# Autodesk Inventor assembly: SE0004AN001_G01_809
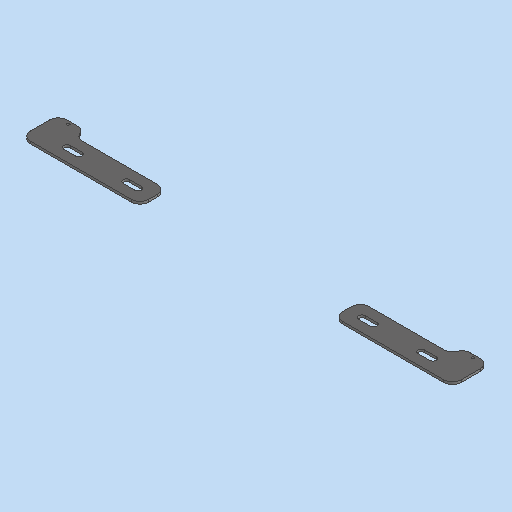
[picture p0: Inventor's stored thumbnail of the model, 512x512]
Saved by Autodesk Inventor 2023.3 (Build 273359000, 359)
## iProperties
RuleStatus: InUse
Created: 2021-07-09
Part Number: SE0004AN001_G01_809
Description: =<RBPARTNOTITLE2>
Document SubType Name: Assembly
Designer: frt9bw
Mass: 553.373 g
Surface Area: 416.53 cm^2
Volume: 72.4798 cm^3
Density: 7.63486 g/cm^3
AnP_Material: =<Material>
AnP_TemplVers: 20200821
RBDOCUMENTTYPE: DRF
RBDOCUMENTVERSION: 00
RBDRAWINGMAINSCALE: 1:1
RBDRAWINGMISSINGSPEC: --
RBDRAWINGVOLUME: --
RBDSV1: 0850
RBGBEDGESIN1: +0,5
RBGBEDGESIN2: +0,2
RBGBEDGESOUT1: -0,3
RBGBEDGESOUT2: -0,1
RBMATERIAL: =<Material>
RBMATMEETS: --
RBMATNO: =<Part Number>
RBPARTMADEOF: --
RBPARTNO: SIEHE MNR
RBPARTNOTITLE1: --
RBPARTSAFETYINDICATOR: --
RBSURFACE: --
RBSURFACE2: --
RBZEDGESNORM: ISO13715:2002-06
RBZGENDIMCLASS: m
RBZGENDIMNORM: ISO 2768-1:1989-11
RBZGENGEOCLASS: H
RBZGENGEONORM: ISO 2768-2:1989-11
RBZSURFACENORM: ISO13D2:2002-02
RBZTOLERANCENORM: ISO 14405-1:2010-12
Author: frt9bw
Keywords: =<RBPARTMADEOF>
Comments: =<RBSURFACE2>
Revision Number: 01
## Documents named in this file (3)
- C:\Users\rea9an\Documents\Inventor\TCAI2412_te1910_EM\AS00000984.iam
- C:\Users\rea9an\Documents\Inventor\TCAI2412_te1910_EM\PT00004801.ipt
- C:\Users\rea9an\Documents\Inventor\TCAI2412_te1910_EM\PT00004810.ipt
## Components (4 placed, 2 different names)
1. PT00004801:1 — Fluchtend:1, Fluchtend:2, Fluchtend:3
2. PT00004810:1
3. PT00004801:2 — Einfügen:2, Fluchtend:2, Fluchtend:3, Passend:1
4. PT00004810:2 — Einfügen:2
## Relationships (6: Flush 3, Insert 2, Mate 1)
- [Insert]: PT00004801:1 ↔ PT00004810:1
- Fluchtend:1 [Flush] (164 mm): PT00004801:1
- Einfügen:2 [Insert]: PT00004801:2 ↔ PT00004810:2
- Fluchtend:2 [Flush]: PT00004801:1 ↔ PT00004801:2
- Fluchtend:3 [Flush]: PT00004801:1 ↔ PT00004801:2
- Passend:1 [Mate] (164 mm): PT00004801:2
## Named parameters: d4_d0 = 0 mm
